# Autodesk Inventor assembly: JET ENGINE ASSEMBLY
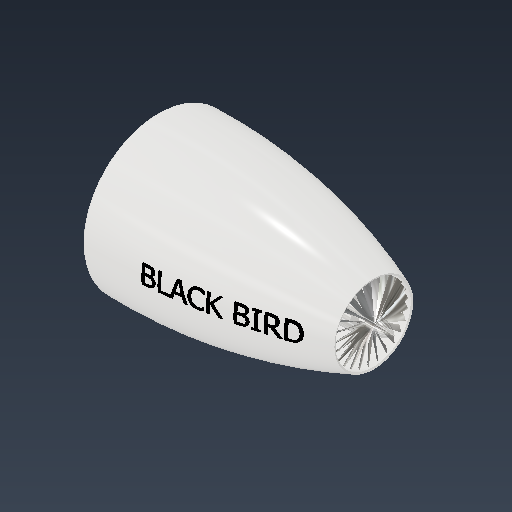
[picture p0: Inventor's stored thumbnail of the model, 512x512]
Saved by Autodesk Inventor 2026.1 (Build 301233020, 233B)
## iProperties
Created: 2026-10-11
Part Number: JET ENGINE ASSEMBLY
Document SubType Name: Assembly
Designer: ADMIN
Author: ADMIN
## Documents named in this file (4)
- C:\Users\ADMIN\Desktop\Jet Engine Design\JET ENGINE ASSEMBLY.iam
- C:\Users\ADMIN\Desktop\Jet Engine Design\HOUSING.ipt
- C:\Users\ADMIN\Desktop\Jet Engine Design\SHAFT.ipt
- C:\Users\ADMIN\Desktop\Jet Engine Design\PROPELLER.ipt
## Components (3 placed, 3 different names)
1. HOUSING:1 — Flush:1, Flush:2, Flush:3, Flush:4, Mate:1, Mate:2, Mate:4
2. SHAFT:1 — Mate:1, Mate:3, Mate:5, Mate:6
3. PROPELLER:1 — Mate:2, Mate:3, Mate:4, Mate:5, Mate:6
## Relationships (10: Mate 6, Flush 4)
- Flush:1: HOUSING:1
- Flush:2: HOUSING:1
- Flush:3: HOUSING:1
- Flush:4: HOUSING:1
- Mate:1: HOUSING:1 ↔ SHAFT:1
- Mate:2: HOUSING:1 ↔ PROPELLER:1
- Mate:3: SHAFT:1 ↔ PROPELLER:1
- Mate:4: HOUSING:1 ↔ PROPELLER:1
- Mate:5: SHAFT:1 ↔ PROPELLER:1
- Mate:6: SHAFT:1 ↔ PROPELLER:1
